# Autodesk Inventor assembly: WheeledBipedalRobot_Assembly
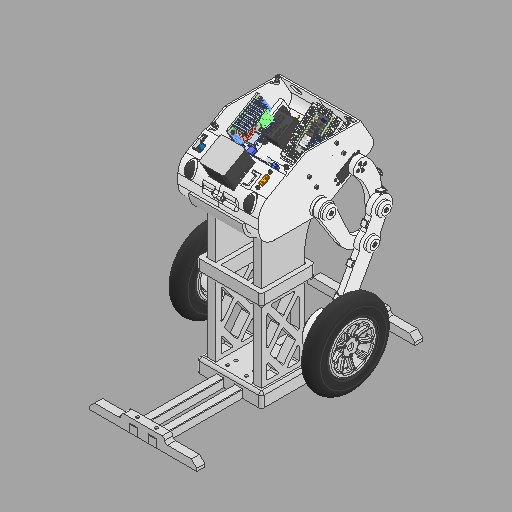
[picture p0: Inventor's stored thumbnail of the model, 512x512]
Saved by Autodesk Inventor 2025 (Build 290162000, 162)
## iProperties
Created: 2024-11-15
Part Number: WheeledBipedalRobot_Assembly
Document SubType Name: Assembly
Designer: OSB
Sending System: Autodesk Inventor 2021
Preprocessor: unknown
Minimum Resolution: 0.01
Sent Units: Millimeter
Translation Standard: IGES 5.3
Model Creation Time: 2020-07-07
Title: S500 Frame
Author: OSB
## Documents named in this file (10)
- C:\Users\OSB\Desktop\SB\1.Projects\4_2\캡스톤 디자인(2)\Modeling\Implementation_Design\Ver_002\WheeledBipedalRobot_withStand_Assembly.iam
- C:\Users\OSB\Desktop\SB\1.Projects\4_2\캡스톤 디자인(2)\Modeling\Implementation_Design\Ver_002\MainBody_Assembly.iam
- C:\Users\OSB\Desktop\SB\1.Projects\4_2\캡스톤 디자인(2)\Modeling\Implementation_Design\Ver_002\ThighLink_Active_Left_Assembly.iam
- C:\Users\OSB\Desktop\SB\1.Projects\4_2\캡스톤 디자인(2)\Modeling\Implementation_Design\Ver_002\ThighLink_Active_Right_Assembly.iam
- C:\Users\OSB\Desktop\SB\1.Projects\4_2\캡스톤 디자인(2)\Modeling\Implementation_Design\Ver_002\ThighLink_Passive_Left_Assembly.iam
- C:\Users\OSB\Desktop\SB\1.Projects\4_2\캡스톤 디자인(2)\Modeling\Implementation_Design\Ver_002\ThighLink_Passive_Right_Assembly.iam
- C:\Users\OSB\Desktop\SB\1.Projects\4_2\캡스톤 디자인(2)\Modeling\Implementation_Design\Ver_002\Calf_Link_Left_Assembly.iam
- C:\Users\OSB\Desktop\SB\1.Projects\4_2\캡스톤 디자인(2)\Modeling\Implementation_Design\Ver_002\Calf_Link_Right_Assembly.iam
- C:\Users\OSB\Desktop\SB\1.Projects\4_2\캡스톤 디자인(2)\Modeling\Implementation_Design\Ver_002\Wheel_Assembly.iam
- C:\Users\OSB\Desktop\SB\1.Projects\4_2\캡스톤 디자인(2)\Modeling\Implementation_Design\Ver_002\Stand_Assembly.iam
## Components (10 placed, 9 different names)
1. MainBody_Assembly:1 [sub-assembly] — 회전:2, 회전:4, 회전:9, 회전:11, 메이트:7, 메이트:8
2. ThighLink_Active_Left_Assembly:1 [sub-assembly] — 회전:2, 각도:1, 회전:10
3. ThighLink_Active_Right_Assembly:1 [sub-assembly] — 회전:4, 각도:2, 회전:12
4. ThighLink_Passive_Left_Assembly:1 [sub-assembly] — 회전:9, 메이트:5
5. ThighLink_Passive_Right_Assembly:1 [sub-assembly] — 회전:11, 메이트:6
6. Calf_Link_Left_Assembly:1 [sub-assembly] — 회전:7, 메이트:3, 회전:10, 메이트:5
7. Calf_Link_Right_Assembly:1 [sub-assembly] — 회전:8, 메이트:4, 회전:12, 메이트:6
8. Wheel_Assembly:1 [sub-assembly] — 회전:7, 메이트:3
9. Wheel_Assembly:2 [sub-assembly] — 회전:8, 메이트:4
10. Stand_Assembly:1 [sub-assembly] — 메이트:7, 메이트:8, 플러쉬:1
## Relationships (17: RevoluteJoint 8, Mate 6, Angle 2, Flush 1)
- 회전:2 [RevoluteJoint]: MainBody_Assembly:1 ↔ ThighLink_Active_Left_Assembly:1
- 회전:4 [RevoluteJoint]: MainBody_Assembly:1 ↔ ThighLink_Active_Right_Assembly:1
- 회전:7 [RevoluteJoint]: Calf_Link_Left_Assembly:1 ↔ Wheel_Assembly:1
- 회전:8 [RevoluteJoint]: Calf_Link_Right_Assembly:1 ↔ Wheel_Assembly:2
- 메이트:3 [Mate]: Calf_Link_Left_Assembly:1 ↔ Wheel_Assembly:1
- 메이트:4 [Mate]: Calf_Link_Right_Assembly:1 ↔ Wheel_Assembly:2
- 각도:1 [Angle] (0 deg): ThighLink_Active_Left_Assembly:1
- 각도:2 [Angle] (0 deg): ThighLink_Active_Right_Assembly:1
- 회전:9 [RevoluteJoint]: MainBody_Assembly:1 ↔ ThighLink_Passive_Left_Assembly:1
- 회전:10 [RevoluteJoint]: ThighLink_Active_Left_Assembly:1 ↔ Calf_Link_Left_Assembly:1
- 메이트:5 [Mate]: ThighLink_Passive_Left_Assembly:1 ↔ Calf_Link_Left_Assembly:1
- 회전:11 [RevoluteJoint]: MainBody_Assembly:1 ↔ ThighLink_Passive_Right_Assembly:1
- 회전:12 [RevoluteJoint]: ThighLink_Active_Right_Assembly:1 ↔ Calf_Link_Right_Assembly:1
- 메이트:6 [Mate]: ThighLink_Passive_Right_Assembly:1 ↔ Calf_Link_Right_Assembly:1
- 메이트:7 [Mate]: MainBody_Assembly:1 ↔ Stand_Assembly:1
- 메이트:8 [Mate]: MainBody_Assembly:1 ↔ Stand_Assembly:1
- 플러쉬:1 [Flush]: Stand_Assembly:1
